# Autodesk Inventor assembly: BoronProbe_2026_non_bellows
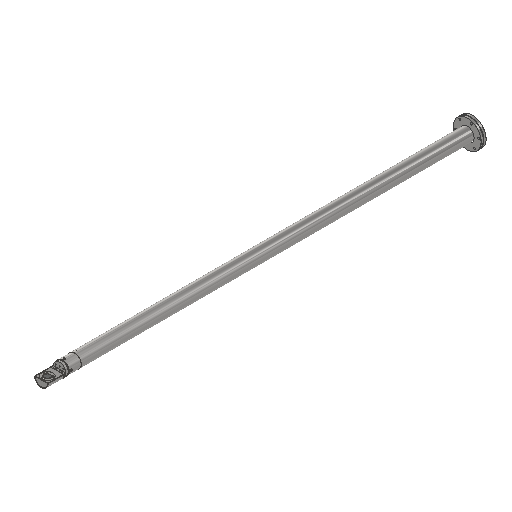
[picture p0: Inventor's stored thumbnail of the model, 512x512]
Saved by Autodesk Inventor 2027.1 (Build 311270010, 270A)
## iProperties
Created: 2026-10-19
Part Number: BoronProbe_2026_non_bellows
Document SubType Name: Assembly
Designer: zetsu
Author: zetsu
## Documents named in this file (6)
- D:\repos\PIHTI\BoronProbe_2026\BoronProbe_2026_non_bellows.iam
- D:\repos\PIHTI\BoronProbe_2026\SampleHolder_1.iam
- D:\repos\PIHTI\BoronProbe_2026\parts\B_pipe_adapter_1.ipt
- D:\repos\PIHTI\BoronProbe_2026\parts\B_probe_pipe_5_for-non-bellows_1.ipt
- D:\repos\PIHTI\BoronProbe_2026\parts\M2-4_screw.ipt
- D:\repos\PIHTI\BoronProbe_2026\parts\ICF70_weld.ipt
## Components (7 placed, 5 different names)
1. B_probe_pipe_5_for-non-bellows_1:1 — メイト:9, メイト:10, メイト:11, メイト:12
2. SampleHolder_1:1 [sub-assembly] — メイト:1, メイト:2
3. B_pipe_adapter_1:1 — メイト:1, メイト:2, メイト:9, メイト:10, 挿入:1, 挿入:2, 挿入:3
4. M2-4_screw:1 — 挿入:1
5. M2-4_screw:2 — 挿入:2
6. M2-4_screw:3 — 挿入:3
7. ICF70_weld:1 — メイト:11, メイト:12
## Relationships (12: Mate 8, Insert 3, Flush 1)
- メイト:1 [Mate]: SampleHolder_1:1 ↔ B_pipe_adapter_1:1
- メイト:2 [Mate]: SampleHolder_1:1 ↔ B_pipe_adapter_1:1
- [Mate]: B_probe_pipe_5_for-non-bellows_1:1 ↔ B_pipe_adapter_1:1
- [Mate]: B_probe_pipe_5_for-non-bellows_1:1 ↔ B_pipe_adapter_1:1
- メイト:9 [Mate]: B_probe_pipe_5_for-non-bellows_1:1 ↔ B_pipe_adapter_1:1
- メイト:10 [Mate]: B_probe_pipe_5_for-non-bellows_1:1 ↔ B_pipe_adapter_1:1
- フラッシュ:1 [Flush] (-161 mm)
- 挿入:1 [Insert]: B_pipe_adapter_1:1 ↔ M2-4_screw:1
- 挿入:2 [Insert]: B_pipe_adapter_1:1 ↔ M2-4_screw:2
- 挿入:3 [Insert]: B_pipe_adapter_1:1 ↔ M2-4_screw:3
- メイト:11 [Mate]: B_probe_pipe_5_for-non-bellows_1:1 ↔ ICF70_weld:1
- メイト:12 [Mate]: B_probe_pipe_5_for-non-bellows_1:1 ↔ ICF70_weld:1
